# Autodesk Inventor assembly: XM430-W350-RR1
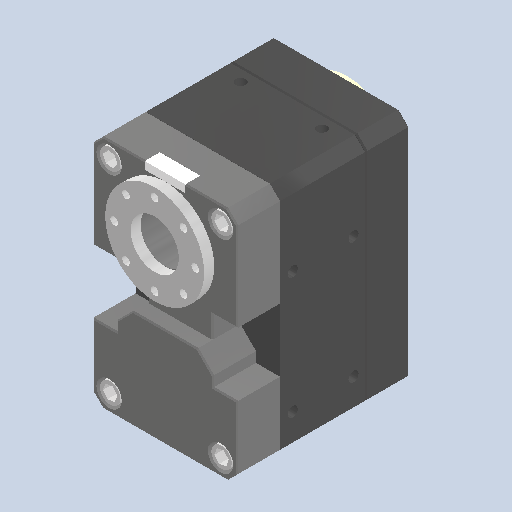
[picture p0: Inventor's stored thumbnail of the model, 512x512]
Saved by Autodesk Inventor 2025.2 (Build 292293000, 293)
## iProperties
Created: 2018-07-05
Part Number: XM430-W350-RR1
Document SubType Name: Assembly
Designer: ricoa
Title: /vol/tmp/translate-329079067709669955/5b3e80553a1eeb103c565669.step
Revision Number: NONE
## Documents named in this file (17)
- C:\Users\ricoa\OneDrive\Desktop\PROYEK AKHIR\project_pororo\XM430-W350-R\XM430-W350-R\XM430-W350-RR1.iam
- C:\Users\ricoa\OneDrive\Desktop\PROYEK AKHIR\project_pororo\XM430-W350-R\XM430-W350-R\Part 1R1.ipt
- C:\Users\ricoa\OneDrive\Desktop\PROYEK AKHIR\project_pororo\XM430-W350-R\XM430-W350-R\Part 2R1.ipt
- C:\Users\ricoa\OneDrive\Desktop\PROYEK AKHIR\project_pororo\XM430-W350-R\XM430-W350-R\Part 3R1.ipt
- C:\Users\ricoa\OneDrive\Desktop\PROYEK AKHIR\project_pororo\XM430-W350-R\XM430-W350-R\Part 4R1.ipt
- C:\Users\ricoa\OneDrive\Desktop\PROYEK AKHIR\project_pororo\XM430-W350-R\XM430-W350-R\Part 5R1.ipt
- C:\Users\ricoa\OneDrive\Desktop\PROYEK AKHIR\project_pororo\XM430-W350-R\XM430-W350-R\Part 6R1.ipt
- C:\Users\ricoa\OneDrive\Desktop\PROYEK AKHIR\project_pororo\XM430-W350-R\XM430-W350-R\Part 7R1.ipt
- C:\Users\ricoa\OneDrive\Desktop\PROYEK AKHIR\project_pororo\XM430-W350-R\XM430-W350-R\Part 8R1.ipt
- C:\Users\ricoa\OneDrive\Desktop\PROYEK AKHIR\project_pororo\XM430-W350-R\XM430-W350-R\Part 9R1.ipt
- C:\Users\ricoa\OneDrive\Desktop\PROYEK AKHIR\project_pororo\XM430-W350-R\XM430-W350-R\Part 10R1.ipt
- C:\Users\ricoa\OneDrive\Desktop\PROYEK AKHIR\project_pororo\XM430-W350-R\XM430-W350-R\Part 11R1.ipt
- C:\Users\ricoa\OneDrive\Desktop\PROYEK AKHIR\project_pororo\XM430-W350-R\XM430-W350-R\Part 12R1.ipt
- C:\Users\ricoa\OneDrive\Desktop\PROYEK AKHIR\project_pororo\XM430-W350-R\XM430-W350-R\Part 13R1.ipt
- C:\Users\ricoa\OneDrive\Desktop\PROYEK AKHIR\project_pororo\XM430-W350-R\XM430-W350-R\Part 14R1.ipt
- C:\Users\ricoa\OneDrive\Desktop\PROYEK AKHIR\project_pororo\XM430-W350-R\XM430-W350-R\Part 15R1.ipt
- C:\Users\ricoa\OneDrive\Desktop\PROYEK AKHIR\project_pororo\XM430-W350-R\XM430-W350-R\Part 16R1.ipt
## Components (16 placed, 16 different names)
1. Part 1R1:1 — Mate:2, Mate:1
2. Part 2R1:1
3. Part 3R1:1
4. Part 4R1:1 — Mate:2, Mate:1
5. Part 5R1:1
6. Part 6R1:1
7. Part 7R1:1
8. Part 8R1:1
9. Part 9R1:1
10. Part 10R1:1
11. Part 11R1:1
12. Part 12R1:1
13. Part 13R1:1
14. Part 14R1:1
15. Part 15R1:1
16. Part 16R1:1
## Relationships (2: Mate 2)
- Mate:2: Part 1R1:1 ↔ Part 4R1:1
- Mate:1: Part 1R1:1 ↔ Part 4R1:1
